# Autodesk Inventor assembly: XT30_hub
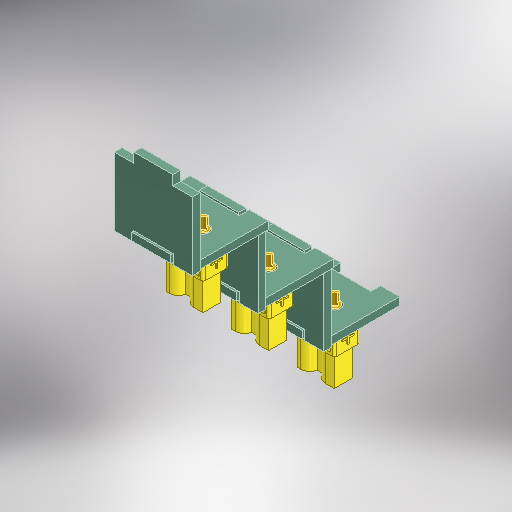
[picture p0: Inventor's stored thumbnail of the model, 512x512]
Saved by Autodesk Inventor 2025.2 (Build 292293000, 293)
## iProperties
Created: 2025-07-29
Part Number: XT30_hub
Document SubType Name: Assembly
Designer: 8326d
Author: 8326d
## Documents named in this file (3)
- C:\Users\8326d\Documents\hobby\rogiken\catchrobo\CAD\Hardware_CAD\Inventor\circuit\XT30_hub.iam
- C:\Users\8326d\Documents\hobby\rogiken\catchrobo\CAD\Hardware_CAD\Inventor\circuit\XT30-hub\XT30-hub\XT30-hub.iam
- C:\Users\8326d\Documents\hobby\rogiken\catchrobo\CAD\Hardware_CAD\Inventor\circuit\XT-con\XT-con\XT-con.iam
## Components (6 placed, 2 different names)
1. XT30-hub:1 [sub-assembly] — メイト:1, フラッシュ:1, メイト:2
2. XT-con:1 [sub-assembly] — メイト:1, フラッシュ:1, メイト:2, メイト:5, メイト:6, メイト:7
3. XT30-hub:2 [sub-assembly] — メイト:5, メイト:6, メイト:7
4. XT-con:2 [sub-assembly] — メイト:10, メイト:11, メイト:12
5. XT30-hub:3 [sub-assembly] — メイト:10, メイト:11, メイト:12
6. XT-con:3 [sub-assembly]
## Relationships (15: Mate 12, Flush 3)
- メイト:1 [Mate]: XT30-hub:1 ↔ XT-con:1
- フラッシュ:1 [Flush]: XT30-hub:1 ↔ XT-con:1
- メイト:2 [Mate]: XT30-hub:1 ↔ XT-con:1
- [Mate]: XT30-hub:2 ↔ XT-con:2
- [Flush]: XT30-hub:2 ↔ XT-con:2
- [Mate]: XT30-hub:2 ↔ XT-con:2
- メイト:5 [Mate]: XT-con:1 ↔ XT30-hub:2
- メイト:6 [Mate]: XT-con:1 ↔ XT30-hub:2
- メイト:7 [Mate]: XT-con:1 ↔ XT30-hub:2
- [Mate]: XT30-hub:3 ↔ XT-con:3
- [Flush]: XT30-hub:3 ↔ XT-con:3
- [Mate]: XT30-hub:3 ↔ XT-con:3
- メイト:10 [Mate]: XT-con:2 ↔ XT30-hub:3
- メイト:11 [Mate]: XT-con:2 ↔ XT30-hub:3
- メイト:12 [Mate]: XT-con:2 ↔ XT30-hub:3
## Named parameters: d3_d2 = 0 mm, d4_d0 = 0 mm, d5_d1 = 0 mm, d9_d2 = 0 mm, d10_d0 = 0 mm, d11_d1 = 0 mm
